# Autodesk Inventor assembly: Assembly1
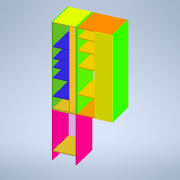
[picture p0: Inventor's stored thumbnail of the model, 180x180]
Saved by Autodesk Inventor 2022.6 (Build 266554000, 554)
## iProperties
Created: 2025-12-10
Part Number: Assembly1
Document SubType Name: Assembly
Designer: Dragos Macovei
Author: Dragos Macovei
## Documents named in this file (12)
- C:\Users\Dragos Macovei\Documents\Inventor_3d_parts\Dulap_Ioana\Assembly1.iam
- C:\Users\Dragos Macovei\Documents\Inventor_3d_parts\Dulap_Ioana\Dulap_Masa_calcat\laterala.ipt
- C:\Users\Dragos Macovei\Documents\Inventor_3d_parts\Dulap_Ioana\Dulap_Masa_calcat\top_bottom_soldat.ipt
- C:\Users\Dragos Macovei\Documents\Inventor_3d_parts\Dulap_Ioana\Dulap_Masa_calcat\perete_despartitor_masina_calcat.ipt
- C:\Users\Dragos Macovei\Documents\Inventor_3d_parts\Dulap_Ioana\Dulap_Masa_calcat\polita_soldat.ipt
- C:\Users\Dragos Macovei\Documents\Inventor_3d_parts\Dulap_Ioana\Dulap_Masa_calcat\front_soldat.ipt
- C:\Users\Dragos Macovei\Documents\Inventor_3d_parts\Dulap_Ioana\DULAP_RUFE\LATERALA.ipt
- C:\Users\Dragos Macovei\Documents\Inventor_3d_parts\Dulap_Ioana\DULAP_RUFE\intaritura_spate_jos_sub_statie.ipt
- C:\Users\Dragos Macovei\Documents\Inventor_3d_parts\Dulap_Ioana\DULAP_RUFE\usa_jos.ipt
- C:\Users\Dragos Macovei\Documents\Inventor_3d_parts\Dulap_Ioana\masina_spalat\top_bottom_masina_spalat.ipt
- C:\Users\Dragos Macovei\Documents\Inventor_3d_parts\Dulap_Ioana\masina_spalat\raft.ipt
- C:\Users\Dragos Macovei\Documents\Inventor_3d_parts\Dulap_Ioana\masina_spalat\usa_suspendat.ipt
## Components (27 placed, 11 different names)
1. laterala:1 — Flush:4, Mate:2, Flush:5, Mate:3, Mate:6, Mate:14, Flush:18, Flush:19, Mate:21, Flush:26, Flush:27
2. laterala:2 — Mate:1, Flush:1, Flush:2, Mate:4, Flush:6, Flush:7, Mate:7, Mate:8, Mate:9, Mate:10, Flush:9, Flush:10, Flush:11, Flush:12, Mate:11, Flush:13, Mate:12, Flush:15, Mate:13, Flush:16, Flush:17
3. top_bottom_soldat:1 — Mate:1, Flush:1, Flush:2, Flush:4, Mate:2, Flush:5, Flush:8, Flush:14
4. top_bottom_soldat:2 — Mate:3, Mate:4, Flush:6, Flush:7, Mate:5, Mate:16, Flush:20
5. perete_despartitor_masina_calcat:1 — Mate:5, Flush:8, Mate:6
6. polita_soldat:1 — Mate:7, Flush:12
7. polita_soldat:2 — Mate:8, Flush:11
8. polita_soldat:3 — Mate:9, Flush:10
9. polita_soldat:4 — Mate:10, Flush:9
10. polita_soldat:5 — Mate:11, Flush:13
11. front_soldat:1 — Mate:12, Flush:14, Flush:15
12. LATERALA:1 — Mate:13, Flush:16, Flush:17, Mate:17, Flush:21, Flush:22, Mate:18, Flush:24
13. LATERALA:2 — Mate:14, Flush:18, Flush:19, Mate:15, Mate:20
14. top_bottom_soldat:3 — Mate:15, Mate:16, Flush:20
15. top_bottom_soldat:4 — Mate:17, Flush:21, Flush:22, Mate:19, Flush:23, Flush:25
16. intaritura_spate_jos_sub_statie:1 — Mate:18, Mate:19, Flush:23
17. usa_jos:1 — Mate:20, Flush:24, Flush:25
18. laterala:3 — Mate:21, Flush:26, Flush:27, Mate:22, Flush:28, Flush:29, Mate:23, Flush:30, Flush:31, Mate:25, Flush:34, Mate:26, Flush:35, Mate:27, Flush:36, Mate:28, Flush:37, Mate:29
19. laterala:4 — Mate:24, Flush:32, Flush:33, Mate:30, Flush:38
20. top_bottom_masina_spalat:1 — Mate:22, Flush:28, Flush:29, Flush:33, Flush:39, Flush:40
21. top_bottom_masina_spalat:2 — Mate:23, Flush:30, Flush:31, Mate:24, Flush:32
22. raft:1 — Mate:28, Flush:37
23. raft:2 — Mate:27, Flush:36
24. raft:3 — Mate:26, Flush:35
25. raft:4 — Mate:25, Flush:34
26. usa_suspendat:1 — Mate:30, Flush:38, Flush:39, Mate:31
27. usa_suspendat:2 — Mate:29, Flush:40, Mate:31
## Relationships (70: Flush 39, Mate 31)
- Mate:1: laterala:2 ↔ top_bottom_soldat:1
- Flush:1: laterala:2 ↔ top_bottom_soldat:1
- Flush:2: laterala:2 ↔ top_bottom_soldat:1
- Flush:4: laterala:1 ↔ top_bottom_soldat:1
- Mate:2: laterala:1 ↔ top_bottom_soldat:1
- Flush:5: laterala:1 ↔ top_bottom_soldat:1
- Mate:3: laterala:1 ↔ top_bottom_soldat:2
- Mate:4: laterala:2 ↔ top_bottom_soldat:2
- Flush:6: laterala:2 ↔ top_bottom_soldat:2
- Flush:7: laterala:2 ↔ top_bottom_soldat:2
- Mate:5: top_bottom_soldat:2 ↔ perete_despartitor_masina_calcat:1
- Flush:8: top_bottom_soldat:1 ↔ perete_despartitor_masina_calcat:1
- Mate:6 (100 mm): laterala:1 ↔ perete_despartitor_masina_calcat:1
- Mate:7: laterala:2 ↔ polita_soldat:1
- Mate:8: laterala:2 ↔ polita_soldat:2
- Mate:9: laterala:2 ↔ polita_soldat:3
- Mate:10: laterala:2 ↔ polita_soldat:4
- Flush:9: laterala:2 ↔ polita_soldat:4
- Flush:10: laterala:2 ↔ polita_soldat:3
- Flush:11: laterala:2 ↔ polita_soldat:2
- Flush:12: laterala:2 ↔ polita_soldat:1
- Mate:11: laterala:2 ↔ polita_soldat:5
- Flush:13: laterala:2 ↔ polita_soldat:5
- Mate:12: laterala:2 ↔ front_soldat:1
- Flush:14: top_bottom_soldat:1 ↔ front_soldat:1
- Flush:15: laterala:2 ↔ front_soldat:1
- Mate:13: laterala:2 ↔ LATERALA:1
- Flush:16: laterala:2 ↔ LATERALA:1
- Flush:17: laterala:2 ↔ LATERALA:1
- Mate:14: laterala:1 ↔ LATERALA:2
- Flush:18: laterala:1 ↔ LATERALA:2
- Flush:19: laterala:1 ↔ LATERALA:2
- Mate:15: LATERALA:2 ↔ top_bottom_soldat:3
- Mate:16: top_bottom_soldat:2 ↔ top_bottom_soldat:3
- Flush:20: top_bottom_soldat:2 ↔ top_bottom_soldat:3
- Mate:17: LATERALA:1 ↔ top_bottom_soldat:4
- Flush:21: LATERALA:1 ↔ top_bottom_soldat:4
- Flush:22 (150 mm): LATERALA:1 ↔ top_bottom_soldat:4
- Mate:18: LATERALA:1 ↔ intaritura_spate_jos_sub_statie:1
- Mate:19: top_bottom_soldat:4 ↔ intaritura_spate_jos_sub_statie:1
- Flush:23: top_bottom_soldat:4 ↔ intaritura_spate_jos_sub_statie:1
- Mate:20: LATERALA:2 ↔ usa_jos:1
- Flush:24: LATERALA:1 ↔ usa_jos:1
- Flush:25: top_bottom_soldat:4 ↔ usa_jos:1
- Mate:21: laterala:1 ↔ laterala:3
- Flush:26: laterala:1 ↔ laterala:3
- Flush:27: laterala:1 ↔ laterala:3
- Mate:22: laterala:3 ↔ top_bottom_masina_spalat:1
- Flush:28: laterala:3 ↔ top_bottom_masina_spalat:1
- Flush:29: laterala:3 ↔ top_bottom_masina_spalat:1
- Mate:23: laterala:3 ↔ top_bottom_masina_spalat:2
- Flush:30: laterala:3 ↔ top_bottom_masina_spalat:2
- Flush:31: laterala:3 ↔ top_bottom_masina_spalat:2
- Mate:24: laterala:4 ↔ top_bottom_masina_spalat:2
- Flush:32: laterala:4 ↔ top_bottom_masina_spalat:2
- Flush:33: laterala:4 ↔ top_bottom_masina_spalat:1
- Mate:25: laterala:3 ↔ raft:4
- Flush:34: laterala:3 ↔ raft:4
- Mate:26: laterala:3 ↔ raft:3
- Flush:35: laterala:3 ↔ raft:3
- Mate:27: laterala:3 ↔ raft:2
- Flush:36: laterala:3 ↔ raft:2
- Mate:28: laterala:3 ↔ raft:1
- Flush:37: laterala:3 ↔ raft:1
- Mate:29: laterala:3 ↔ usa_suspendat:2
- Mate:30: laterala:4 ↔ usa_suspendat:1
- Flush:38: laterala:4 ↔ usa_suspendat:1
- Flush:39: top_bottom_masina_spalat:1 ↔ usa_suspendat:1
- Flush:40: top_bottom_masina_spalat:1 ↔ usa_suspendat:2
- Mate:31: usa_suspendat:1 ↔ usa_suspendat:2
